# Autodesk Inventor assembly: Assembly1
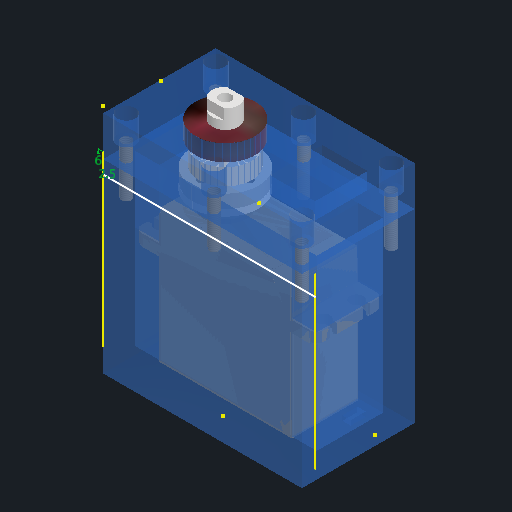
[picture p0: Inventor's stored thumbnail of the model, 512x512]
Saved by Autodesk Inventor 2027 (Build 310192060, 192F)
## iProperties
Created: 2026-08-12
Part Number: Assembly1
Document SubType Name: Assembly
Designer: Laptop
Author: Laptop
## iProperties of the stored document Servo_8120MG.iam
Company: none
Created: 2026-04-17
Part Number: Product3
Description: CATIA V5 STEP Exchange
Document SubType Name: Assembly
Designer: Laptop
Authority: none
Sending System: CATIA V5 STEP AP214 v3
Preprocessor: CATIA Version 5-6 Release 2023 SP4
Title: D:\Work it\EcoLid\V9_new Gen\Servo_8120MG.stp
Author: none
## iProperties of the stored document servo motor_8120MG.ipt
Created: 2026-08-12
Part Number: servo motor_8120MG
Material: Generic
Document SubType Name: Modeling
Designer: Laptop
Density: 1 g/cm^3
Appearance: Default
Author: Laptop
## iProperties of the stored document Servo horn v2.ipt
Created: 2026-08-12
Part Number: Servo horn
Material: Generic
Document SubType Name: Modeling
Designer: Laptop
Density: 1 g/cm^3
Appearance: Default
Author: Laptop
## Documents named in this file (12)
- D:\Year2\đồ án tốt nghịp\đồ án tốt nghiệp v2\hộp v5\Workgroups\NotInProject\Assembly1.iam
- **D:\Year2\đồ án tốt nghịp\đồ án tốt nghiệp v2\hộp v5\Workgroups\NotInProject\Assembly1.iam*LocalDocs*xAaaaavbaAaaaaaaaAaaaayyeQa*Servo_8120MG.iam
- D:\Year2\đồ án tốt nghịp\đồ án tốt nghiệp v2\hộp v5\Workgroups\NotInProject\cátrục (1).ipt
- D:\Year2\đồ án tốt nghịp\đồ án tốt nghiệp v2\hộp v5\Workgroups\NotInProject\cáhộp servo (2) (1).ipt
- D:\Year2\đồ án tốt nghịp\đồ án tốt nghiệp v2\hộp v5\Workgroups\NotInProject\cánap tren servo_MIR_MIR.ipt
- D:\Year2\đồ án tốt nghịp\đồ án tốt nghiệp v2\hộp v5\Workgroups\NotInProject\bạc đạn 8x16x5 2rs.ipt
- D:\Year2\đồ án tốt nghịp\đồ án tốt nghiệp v2\hộp v5\Workgroups\NotInProject\phớt chặn dầu 8x18x5.ipt
- D:\Year2\đồ án tốt nghịp\đồ án tốt nghiệp v2\hộp v5\Workgroups\NotInProject\Servo-9imod-DS35MG-180.ipt
- D:\Year2\đồ án tốt nghịp\đồ án tốt nghiệp v2\hộp v5\Workgroups\NotInProject\Servo_8120MG.stp
- **D:\Downloads\Assembly1.iam*LocalDocs*xAaaaavbaAaaaaaaaAaaaayyeQa*Servo_8120MG.iam
- **D:\Downloads\Assembly1.iam*LocalDocs*xAaaaqedaAaaaaaaaAaaaap5mWf*Servo horn v2.ipt
- **D:\Downloads\Assembly1.iam*LocalDocs*xAaaaapbaAaaaaaaaAaaaqywvQd*servo motor_8120MG.ipt
## Components (7 placed, 7 different names)
1. cáhộp servo (2) (1):1 — Rigid:1, Rigid:2, Rigid:3
2. cánap tren servo_MIR_MIR:1 — Rotational:2, Rotational:3, Rigid:3
3. bạc đạn 8x16x5 2rs:1 — Rotational:2
4. phớt chặn dầu 8x18x5:1 — Rotational:3
5. Servo_8120MG:1 [sub-assembly] — Rigid:1, Rotational:1, Mate:1
6. cátrục (1):1 — Rotational:1, Mate:1
7. Servo-9imod-DS35MG-180:1 — Rigid:2
## Relationships (7: WeldJoint 3, RevoluteJoint 3, Mate 1)
- Rigid:1 [WeldJoint] (-0.5 mm): cáhộp servo (2) (1):1 ↔ Servo_8120MG:1
- Rigid:2 [WeldJoint]: cáhộp servo (2) (1):1 ↔ Servo-9imod-DS35MG-180:1
- Rotational:1 [RevoluteJoint]: Servo_8120MG:1 ↔ cátrục (1):1
- Mate:1: Servo_8120MG:1 ↔ cátrục (1):1
- Rotational:2 [RevoluteJoint]: cánap tren servo_MIR_MIR:1 ↔ bạc đạn 8x16x5 2rs:1
- Rotational:3 [RevoluteJoint]: cánap tren servo_MIR_MIR:1 ↔ phớt chặn dầu 8x18x5:1
- Rigid:3 [WeldJoint]: cáhộp servo (2) (1):1 ↔ cánap tren servo_MIR_MIR:1
## Named parameters: Finish1_Area = 32.64, Finish2_Area = 29.2463, Finish3_Area = 228.404, Finish4_Area = 102.374, Finish5_Area = 0.333911
note: some values were not read from the file. Shown as the stored number, unit unknown: "Finish1_Area", "Finish2_Area", "Finish3_Area", "Finish4_Area", "Finish5_Area".
